# Autodesk Inventor assembly: S45
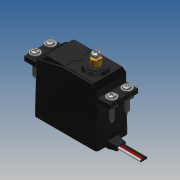
[picture p0: Inventor's stored thumbnail of the model, 180x180]
Saved by Autodesk Inventor 2022.1 (Build 261234000, 234)
## iProperties
Created: 2021-08-13
Part Number: S45
Document SubType Name: Assembly
Designer: dotwibo2
Description: ONYX STANDARD METAL GEAR SERVO
Vendor: ONYX
Vendor Part No: S45
UOFM: EACH
MAKE_OR_BUY: M
PURCH_QTY: 1
Author: dotwibo2
Title: ONYX STANDARD METAL GEAR SERVO
## Documents named in this file (6)
- C:\IV2022WorkFolder\Designs\Bob\ONYX\S45 ONYX STANDARD METAL GEAR SERVO.iam
- C:\IV2022WorkFolder\Designs\Bob\ONYX\S45 ONYX STANDARD METAL GEAR SERVO.ipt
- C:\IV2022WorkFolder\Designs\Bob\ONYX\S45 ONYX STANDARD METAL GEAR SERVO (EYELET).ipt
- C:\IV2022WorkFolder\Designs\Bob\ONYX\S45 ONYX STANDARD METAL GEAR SERVO (GROMMET).ipt
- C:\IV2022WorkFolder\Designs\Bob\ONYX\S45 ONYX STANDARD METAL GEAR SERVO (SCREW).ipt
- C:\IV2022WorkFolder\Designs\Bob\ONYX\S45 ONYX STANDARD METAL GEAR SERVO (M3 SCREW).ipt
## Components (14 placed, 5 different names)
1. S45 ONYX STANDARD METAL GEAR SERVO:1 — Flush:1, Flush:2, Flush:3, Insert:2, Insert:10, Insert:11, Insert:12, Insert:13
2. S45 ONYX STANDARD METAL GEAR SERVO (EYELET):1 — Insert:1, Insert:3
3. S45 ONYX STANDARD METAL GEAR SERVO (GROMMET):1 — Insert:1, Insert:2
4. S45 ONYX STANDARD METAL GEAR SERVO (SCREW):1 — Insert:3
5. S45 ONYX STANDARD METAL GEAR SERVO (EYELET):2
6. S45 ONYX STANDARD METAL GEAR SERVO (GROMMET):2 — Insert:10
7. S45 ONYX STANDARD METAL GEAR SERVO (SCREW):2
8. S45 ONYX STANDARD METAL GEAR SERVO (EYELET):3
9. S45 ONYX STANDARD METAL GEAR SERVO (GROMMET):3 — Insert:11
10. S45 ONYX STANDARD METAL GEAR SERVO (SCREW):3
11. S45 ONYX STANDARD METAL GEAR SERVO (EYELET):4
12. S45 ONYX STANDARD METAL GEAR SERVO (GROMMET):4 — Insert:12
13. S45 ONYX STANDARD METAL GEAR SERVO (SCREW):4
14. S45 ONYX STANDARD METAL GEAR SERVO (M3 SCREW):1 — Insert:13
## Relationships (16: Insert 13, Flush 3)
- Flush:1: S45 ONYX STANDARD METAL GEAR SERVO:1
- Flush:2: S45 ONYX STANDARD METAL GEAR SERVO:1
- Flush:3: S45 ONYX STANDARD METAL GEAR SERVO:1
- Insert:1: S45 ONYX STANDARD METAL GEAR SERVO (EYELET):1 ↔ S45 ONYX STANDARD METAL GEAR SERVO (GROMMET):1
- Insert:2: S45 ONYX STANDARD METAL GEAR SERVO:1 ↔ S45 ONYX STANDARD METAL GEAR SERVO (GROMMET):1
- Insert:3: S45 ONYX STANDARD METAL GEAR SERVO (EYELET):1 ↔ S45 ONYX STANDARD METAL GEAR SERVO (SCREW):1
- [Insert]: S45 ONYX STANDARD METAL GEAR SERVO (EYELET):2 ↔ S45 ONYX STANDARD METAL GEAR SERVO (GROMMET):2
- [Insert]: S45 ONYX STANDARD METAL GEAR SERVO (EYELET):2 ↔ S45 ONYX STANDARD METAL GEAR SERVO (SCREW):2
- [Insert]: S45 ONYX STANDARD METAL GEAR SERVO (EYELET):3 ↔ S45 ONYX STANDARD METAL GEAR SERVO (GROMMET):3
- [Insert]: S45 ONYX STANDARD METAL GEAR SERVO (EYELET):3 ↔ S45 ONYX STANDARD METAL GEAR SERVO (SCREW):3
- [Insert]: S45 ONYX STANDARD METAL GEAR SERVO (EYELET):4 ↔ S45 ONYX STANDARD METAL GEAR SERVO (GROMMET):4
- [Insert]: S45 ONYX STANDARD METAL GEAR SERVO (EYELET):4 ↔ S45 ONYX STANDARD METAL GEAR SERVO (SCREW):4
- Insert:10: S45 ONYX STANDARD METAL GEAR SERVO:1 ↔ S45 ONYX STANDARD METAL GEAR SERVO (GROMMET):2
- Insert:11: S45 ONYX STANDARD METAL GEAR SERVO:1 ↔ S45 ONYX STANDARD METAL GEAR SERVO (GROMMET):3
- Insert:12: S45 ONYX STANDARD METAL GEAR SERVO:1 ↔ S45 ONYX STANDARD METAL GEAR SERVO (GROMMET):4
- Insert:13 (1.06 mm): S45 ONYX STANDARD METAL GEAR SERVO:1 ↔ S45 ONYX STANDARD METAL GEAR SERVO (M3 SCREW):1
## Named parameters: d6_d5 = 0 mm, d7_d3 = 0 mm, d8_d5 = 0 mm, d9_d3 = 0 mm, d10_d5 = 0 mm, d11_d3 = 0 mm
